# Autodesk Inventor assembly: FINAL ASSEMBLY
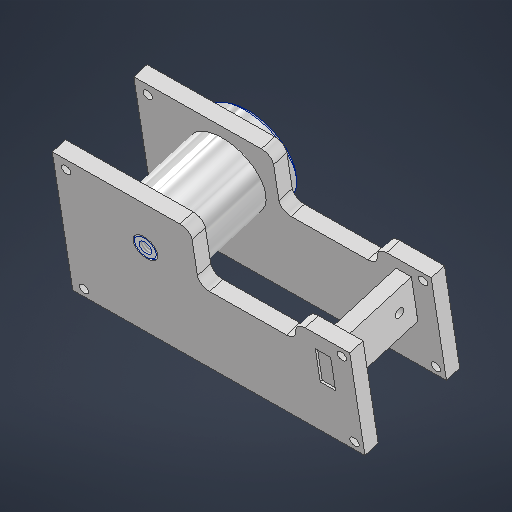
[picture p0: Inventor's stored thumbnail of the model, 512x512]
Saved by Autodesk Inventor 2026.1 (Build 301233020, 233B)
## iProperties
Created: 2026-04-16
Part Number: FINAL ASSEMBLY
Document SubType Name: Assembly
Designer: royka
Author: royka
## Documents named in this file (5)
- C:\Users\royka\OneDrive - University of Staffordshire\L4 ASSIGNMENT FILES\sem 2\design and practice\FINAL ASSEMBLY .iam
- C:\Users\royka\OneDrive - University of Staffordshire\L4 ASSIGNMENT FILES\sem 2\design and practice\1.ipt
- C:\Users\royka\OneDrive - University of Staffordshire\L4 ASSIGNMENT FILES\sem 2\design and practice\2.ipt
- C:\Users\royka\OneDrive - University of Staffordshire\L4 ASSIGNMENT FILES\sem 2\design and practice\3.ipt
- C:\Users\royka\OneDrive - University of Staffordshire\L4 ASSIGNMENT FILES\sem 2\design and practice\CNC.ipt
## Components (4 placed, 4 different names)
1. 1:1 — Rigid:1, Insert:1
2. 2:1 — Rigid:1, Rigid:2
3. 3:1 — Rigid:2
4. CNC:1 — Insert:1
## Relationships (3: WeldJoint 2, Insert 1)
- Rigid:1 [WeldJoint]: 1:1 ↔ 2:1
- Rigid:2 [WeldJoint]: 2:1 ↔ 3:1
- Insert:1: 1:1 ↔ CNC:1
